# Autodesk Inventor assembly: MN0542AN110_G03_001
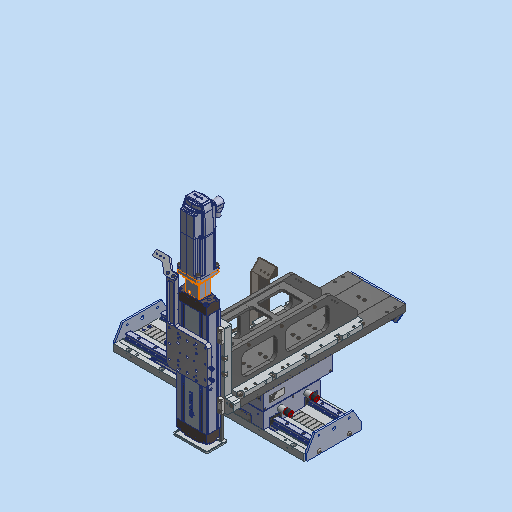
[picture p0: Inventor's stored thumbnail of the model, 512x512]
Saved by Autodesk Inventor 2023.3 (Build 273359000, 359)
## iProperties
Created: 2021-01-21
Part Number: MN0542AN110_G03_001
Description: =<RBPARTNOTITLE2>
Document SubType Name: Baugruppe
Designer: ric7an
Mass: 100000 g
Surface Area: 43358 cm^2
Volume: 17382.6 cm^3
Density: 5.75287 g/cm^3
Vendor: Weiss
Sending System: SolidWorks 2017
Preprocessor: SwSTEP 2.0
RBPARTMADEOF: CSS 3A1005554
RBDRAWINGMISSINGSPEC: --
AnP_Kategorie: 11
RBPARTNOTITLE2: 3-Achssystem (370 x 300 x 200)
RBGBREMARKSINDEX: E
RBSURFACE: --
RBPARTNOTITLE1: 3-axis-system (370 x 300 x 200)
AnP_Material: =<Material>
RBMATERIAL: =<Material>
RBMATNO: =<Part Number>
RBPARTNO: SIEHE MNR
Keywords: =<RBPARTMADEOF>
Comments: =<RBSURFACE2>
Revision Number: 01
## Documents named in this file (3)
- C:\Users\rea9an\Documents\Inventor\TCAI2412_te1910_EM\AS00000973.iam
- C:\Users\rea9an\Documents\Inventor\TCAI2412_te1910_EM\PT00004274.iam
- C:\Users\rea9an\Documents\Inventor\TCAI2412_te1910_EM\AS00000974.iam
## Components (2 placed, 2 different names)
1. PT00004274:1 [sub-assembly] — Fluchtend:1, Fluchtend:2, Passend:1
2. AS00000974:1 [sub-assembly] — Fluchtend:1, Fluchtend:2, Passend:1
## Relationships (3: Flush 2, Mate 1)
- Fluchtend:1 [Flush] (44 mm): PT00004274:1 ↔ AS00000974:1
- Fluchtend:2 [Flush]: PT00004274:1 ↔ AS00000974:1
- Passend:1 [Mate]: PT00004274:1 ↔ AS00000974:1
